# Autodesk Inventor assembly: ASM_grand_Robot
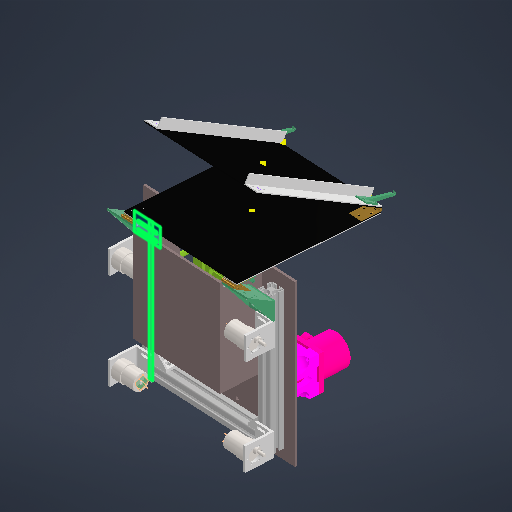
[picture p0: Inventor's stored thumbnail of the model, 512x512]
Saved by Autodesk Inventor 2026 (Build 300175000, 175)
## iProperties
Created: 2025-05-01
Part Number: ASM_grand_Robot
Document SubType Name: Assembly
Designer: karle
Author: karle
## Documents named in this file (9)
- C:\Users\remg9\OneDrive - HESSO\P2511_Dossier_partage_RVEZ\01_Robot\0101_CAO\ASM_grand_Robot.iam
- C:\Users\remg9\OneDrive - HESSO\P2511_Dossier_partage_RVEZ\01_Robot\0101_CAO\0_Châssis\02_Grand Châssis\02_ASM_châssis_Proto.iam
- C:\Users\remg9\OneDrive - HESSO\P2511_Dossier_partage_RVEZ\01_Robot\0101_CAO\Moteur\Support moteur.ipt
- C:\Users\remg9\OneDrive - HESSO\P2511_Dossier_partage_RVEZ\01_Robot\0101_CAO\2_Stabil\Stabilsateur1_2.iam
- C:\Users\remg9\OneDrive - HESSO\P2511_Dossier_partage_RVEZ\01_Robot\0101_CAO\plateau_grand_robot.ipt
- C:\Users\remg9\OneDrive - HESSO\P2511_Dossier_partage_RVEZ\01_Robot\0101_CAO\5_Pompe\5_2_supports_moteur_pompe.ipt
- C:\Users\remg9\OneDrive - HESSO\P2511_Dossier_partage_RVEZ\01_Robot\0101_CAO\5_Pompe\5_1_pompe_model_1.1.ipt
- C:\Users\remg9\OneDrive - HESSO\P2511_Dossier_partage_RVEZ\01_Robot\0101_CAO\Moteur\modelcraftrb3500300001\modelcraftrb3500300001\modelcraftrb3500300001.ipt
- C:\Users\remg9\OneDrive - HESSO\P2511_Dossier_partage_RVEZ\01_Robot\0101_CAO\01_pont\1_pont.iam
## Components (14 placed, 8 different names)
1. 02_ASM_châssis_Proto:1 [sub-assembly] — Mate:3, Flush:1, Mate:5, Mate:6, Flush:9, Mate:7, Flush:4, Flush:5, Mate:9, Flush:7, Mate:10, Mate:12, Mate:13, Flush:10, Mate:14, Mate:15, Flush:11, Mate:16, Flush:12, Flush:13
2. Support moteur:1 — Mate:3, Flush:1, Mate:5, Insert:13, Insert:14
3. Support moteur:2 — Mate:6, Flush:9, Insert:9, Insert:10, Mate:14
4. Support moteur:3 — Mate:9, Flush:7, Mate:10, Insert:11, Insert:12
5. Support moteur:4 — Mate:7, Flush:4, Flush:5, Insert:7, Insert:8, Mate:15, Flush:11
6. Stabilsateur1_2:1 [sub-assembly] — Insert:1, Insert:2
7. plateau_grand_robot:1 — Mate:12, Mate:13, Flush:10, Insert:1, Insert:2, Insert:3, Insert:4
8. 5_2_supports_moteur_pompe:1 — Insert:3, Insert:4, Insert:5, Insert:6
9. 5_1_pompe_model_1.1:1 — Insert:5, Insert:6
10. modelcraftrb3500300001:1 — Insert:7, Insert:8
11. modelcraftrb3500300001:2 — Insert:9, Insert:10
12. modelcraftrb3500300001:3 — Insert:13, Insert:14
13. modelcraftrb3500300001:4 — Insert:11, Insert:12
14. 1_pont:1 [sub-assembly] — Mate:16, Flush:12, Flush:13
## Relationships (34: Insert 14, Mate 11, Flush 9)
- Mate:3 (-10 mm): 02_ASM_châssis_Proto:1 ↔ Support moteur:1
- Flush:1: 02_ASM_châssis_Proto:1 ↔ Support moteur:1
- Mate:5: 02_ASM_châssis_Proto:1 ↔ Support moteur:1
- Mate:6: 02_ASM_châssis_Proto:1 ↔ Support moteur:2
- Flush:9 (-10 mm): 02_ASM_châssis_Proto:1 ↔ Support moteur:2
- Mate:7: 02_ASM_châssis_Proto:1 ↔ Support moteur:4
- Flush:4 (10 mm): 02_ASM_châssis_Proto:1 ↔ Support moteur:4
- Flush:5 (40 mm): 02_ASM_châssis_Proto:1 ↔ Support moteur:4
- Mate:9: 02_ASM_châssis_Proto:1 ↔ Support moteur:3
- Flush:7 (-10 mm): 02_ASM_châssis_Proto:1 ↔ Support moteur:3
- Mate:10: 02_ASM_châssis_Proto:1 ↔ Support moteur:3
- Mate:12: 02_ASM_châssis_Proto:1 ↔ plateau_grand_robot:1
- Mate:13 (22.5 mm): 02_ASM_châssis_Proto:1 ↔ plateau_grand_robot:1
- Flush:10 (22.5 mm): 02_ASM_châssis_Proto:1 ↔ plateau_grand_robot:1
- Insert:1: Stabilsateur1_2:1 ↔ plateau_grand_robot:1
- Insert:2: Stabilsateur1_2:1 ↔ plateau_grand_robot:1
- Insert:3: plateau_grand_robot:1 ↔ 5_2_supports_moteur_pompe:1
- Insert:4: plateau_grand_robot:1 ↔ 5_2_supports_moteur_pompe:1
- Insert:5: 5_2_supports_moteur_pompe:1 ↔ 5_1_pompe_model_1.1:1
- Insert:6: 5_2_supports_moteur_pompe:1 ↔ 5_1_pompe_model_1.1:1
- Insert:7: Support moteur:4 ↔ modelcraftrb3500300001:1
- Insert:8: Support moteur:4 ↔ modelcraftrb3500300001:1
- Insert:9: Support moteur:2 ↔ modelcraftrb3500300001:2
- Insert:10: Support moteur:2 ↔ modelcraftrb3500300001:2
- Insert:11: Support moteur:3 ↔ modelcraftrb3500300001:4
- Insert:12: Support moteur:3 ↔ modelcraftrb3500300001:4
- Insert:13: Support moteur:1 ↔ modelcraftrb3500300001:3
- Insert:14: Support moteur:1 ↔ modelcraftrb3500300001:3
- Mate:14 (40 mm): 02_ASM_châssis_Proto:1 ↔ Support moteur:2
- Mate:15 (40 mm): 02_ASM_châssis_Proto:1 ↔ Support moteur:4
- Flush:11 (40 mm): 02_ASM_châssis_Proto:1 ↔ Support moteur:4
- Mate:16: 02_ASM_châssis_Proto:1 ↔ 1_pont:1
- Flush:12: 02_ASM_châssis_Proto:1 ↔ 1_pont:1
- Flush:13 (-20.5 mm): 02_ASM_châssis_Proto:1 ↔ 1_pont:1
